# Autodesk Inventor assembly: Base_Highwonder_Acoplado
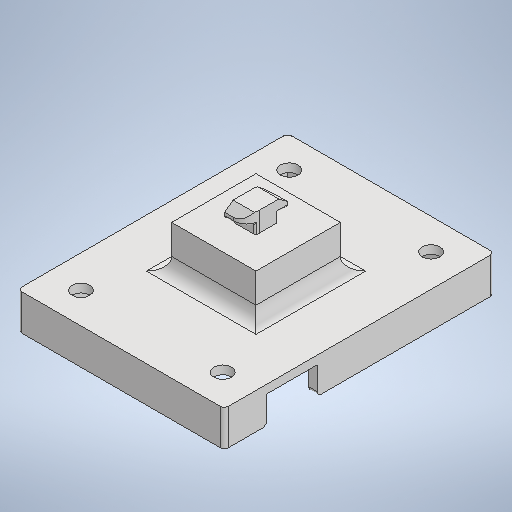
[picture p0: Inventor's stored thumbnail of the model, 512x512]
Saved by Autodesk Inventor 2025.3 (Build 293356030, 356C)
## iProperties
Created: 2026-06-30
Part Number: Base_Highwonder_Acoplado
Document SubType Name: Assembly
Designer: pablo
Author: pablo
## Documents named in this file (3)
- C:\Users\pablo\OneDrive - Universidad del Valle de Guatemala\Documentos\9 Semestre\Tesis\INVENTOR_TESIS\Base_Highwonder_Acoplado.iam
- C:\Users\pablo\OneDrive - Universidad del Valle de Guatemala\Documentos\9 Semestre\Tesis\INVENTOR_TESIS\Agarrador_20x20.ipt
- C:\Users\pablo\OneDrive - Universidad del Valle de Guatemala\Documentos\9 Semestre\Tesis\INVENTOR_TESIS\Base_Controlador_Highwonder.ipt
## Components (2 placed, 2 different names)
1. Agarrador_20x20:1 — Mate:1, Flush:1, Flush:2
2. Base_Controlador_Highwonder:1 — Mate:1, Flush:1, Flush:2
## Relationships (3: Flush 2, Mate 1)
- Mate:1: Agarrador_20x20:1 ↔ Base_Controlador_Highwonder:1
- Flush:1 (7.4 mm): Agarrador_20x20:1 ↔ Base_Controlador_Highwonder:1
- Flush:2 (7.35 mm): Agarrador_20x20:1 ↔ Base_Controlador_Highwonder:1
